# Autodesk Inventor assembly: horizon
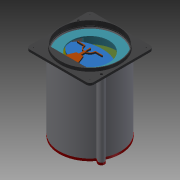
[picture p0: Inventor's stored thumbnail of the model, 180x180]
Saved by Autodesk Inventor 2014 (Build 180170000, 170)
## iProperties
Created: 2014-09-19
Part Number: horizon
Document SubType Name: Assembly
Designer: brodhaq
Author: brodhaq
## Documents named in this file (12)
- D:\Dokumenty\FS_utts\hardware_sell\pristroje\horizon\horizon.iam
- D:\Dokumenty\FS_utts\hardware_sell\pristroje\horizon\roll_back.ipt
- D:\Dokumenty\FS_utts\hardware_sell\pristroje\horizon\roll_body.ipt
- D:\Dokumenty\FS_utts\hardware_sell\pristroje\horizon\Servo HXT900 Micro.ipt
- D:\Dokumenty\FS_utts\hardware_sell\pristroje\horizon\servo_arm.ipt
- D:\Dokumenty\FS_utts\hardware_sell\pristroje\horizon\bezzel.ipt
- D:\Dokumenty\FS_utts\hardware_sell\pristroje\horizon\body_pitch.ipt
- D:\Dokumenty\FS_utts\hardware_sell\pristroje\horizon\bocnice.ipt
- D:\Dokumenty\FS_utts\hardware_sell\pristroje\horizon\roll_back_behind.ipt
- D:\Dokumenty\FS_utts\hardware_sell\pristroje\horizon\sroubM3.ipt
- D:\Dokumenty\FS_utts\hardware_sell\pristroje\horizon\roll_back_behind_LAST.ipt
- D:\Dokumenty\FS_utts\hardware_sell\pristroje\horizon\obal.ipt
## Components (15 placed, 11 different names)
1. roll_back:1 — Proti sobě:1, Stejný směr:1, Proti sobě:2, Proti sobě:3, Proti sobě:4, Proti sobě:5, Proti sobě:9
2. roll_body:1 — Proti sobě:1, Stejný směr:1, Proti sobě:2
3. servo_arm:1 — Proti sobě:6
4. Servo HXT900 Micro:1 — Proti sobě:3, Proti sobě:4, Proti sobě:5, Proti sobě:6, Proti sobě:10, Proti sobě:11, Proti sobě:12
5. bezzel:1 — Proti sobě:24, Proti sobě:25, Proti sobě:26, Úhel:2
6. body_pitch:1 — Proti sobě:7, Stejný směr:2, Stejný směr:3, Proti sobě:8, Stejný směr:4, Stejný směr:5, Úhel:2
7. bocnice:2 — Proti sobě:7, Stejný směr:2, Stejný směr:3, Proti sobě:13, Proti sobě:14
8. bocnice:3 — Proti sobě:8, Stejný směr:4, Stejný směr:5, Proti sobě:9, Proti sobě:15, Tečnost:2
9. roll_back_behind:1 — Proti sobě:10, Proti sobě:11, Proti sobě:12, Tečnost:1, Proti sobě:16, Proti sobě:17, Úhel:1
10. sroubM3:1 — Proti sobě:13, Proti sobě:14, Tečnost:1
11. sroubM3:2 — Proti sobě:15, Tečnost:2
12. servo_arm:2 — Proti sobě:16, Proti sobě:17, Proti sobě:18, Proti sobě:19
13. Servo HXT900 Micro:2 — Proti sobě:18, Proti sobě:19, Úhel:1, Proti sobě:20, Proti sobě:21, Proti sobě:22
14. roll_back_behind_LAST:1 — Proti sobě:20, Proti sobě:21, Proti sobě:22, Proti sobě:23, Stejný směr:6, Proti sobě:27
15. obal:1 — Proti sobě:23, Stejný směr:6, Proti sobě:24, Proti sobě:25, Proti sobě:26, Proti sobě:27
## Relationships (37: Mate 27, Flush 6, Tangent 2, Angle 2)
- Proti sobě:1 [Mate]: roll_back:1 ↔ roll_body:1
- Stejný směr:1 [Flush]: roll_back:1 ↔ roll_body:1
- Proti sobě:2 [Mate]: roll_back:1 ↔ roll_body:1
- Proti sobě:3 [Mate]: roll_back:1 ↔ Servo HXT900 Micro:1
- Proti sobě:4 [Mate]: roll_back:1 ↔ Servo HXT900 Micro:1
- Proti sobě:5 [Mate]: roll_back:1 ↔ Servo HXT900 Micro:1
- Proti sobě:6 [Mate]: servo_arm:1 ↔ Servo HXT900 Micro:1
- Proti sobě:7 [Mate]: body_pitch:1 ↔ bocnice:2
- Stejný směr:2 [Flush]: body_pitch:1 ↔ bocnice:2
- Stejný směr:3 [Flush]: body_pitch:1 ↔ bocnice:2
- Proti sobě:8 [Mate]: body_pitch:1 ↔ bocnice:3
- Stejný směr:4 [Flush]: body_pitch:1 ↔ bocnice:3
- Stejný směr:5 [Flush]: body_pitch:1 ↔ bocnice:3
- Proti sobě:9 [Mate]: roll_back:1 ↔ bocnice:3
- Proti sobě:10 [Mate]: Servo HXT900 Micro:1 ↔ roll_back_behind:1
- Proti sobě:11 [Mate]: Servo HXT900 Micro:1 ↔ roll_back_behind:1
- Proti sobě:12 [Mate]: Servo HXT900 Micro:1 ↔ roll_back_behind:1
- Proti sobě:13 [Mate]: bocnice:2 ↔ sroubM3:1
- Proti sobě:14 [Mate]: bocnice:2 ↔ sroubM3:1
- Tečnost:1 [Tangent]: roll_back_behind:1 ↔ sroubM3:1
- Proti sobě:15 [Mate]: bocnice:3 ↔ sroubM3:2
- Tečnost:2 [Tangent]: bocnice:3 ↔ sroubM3:2
- Proti sobě:16 [Mate]: roll_back_behind:1 ↔ servo_arm:2
- Proti sobě:17 [Mate]: roll_back_behind:1 ↔ servo_arm:2
- Proti sobě:18 [Mate]: servo_arm:2 ↔ Servo HXT900 Micro:2
- Proti sobě:19 [Mate]: servo_arm:2 ↔ Servo HXT900 Micro:2
- Úhel:1 [Angle] (0 deg): roll_back_behind:1 ↔ Servo HXT900 Micro:2
- Proti sobě:20 [Mate]: Servo HXT900 Micro:2 ↔ roll_back_behind_LAST:1
- Proti sobě:21 [Mate]: Servo HXT900 Micro:2 ↔ roll_back_behind_LAST:1
- Proti sobě:22 [Mate]: Servo HXT900 Micro:2 ↔ roll_back_behind_LAST:1
- Proti sobě:23 [Mate]: roll_back_behind_LAST:1 ↔ obal:1
- Stejný směr:6 [Flush]: roll_back_behind_LAST:1 ↔ obal:1
- Proti sobě:24 [Mate]: bezzel:1 ↔ obal:1
- Proti sobě:25 [Mate]: bezzel:1 ↔ obal:1
- Proti sobě:26 [Mate]: bezzel:1 ↔ obal:1
- Úhel:2 [Angle] (0 deg): bezzel:1 ↔ body_pitch:1
- Proti sobě:27 [Mate]: roll_back_behind_LAST:1 ↔ obal:1
